# Autodesk Inventor assembly: rotate-translate
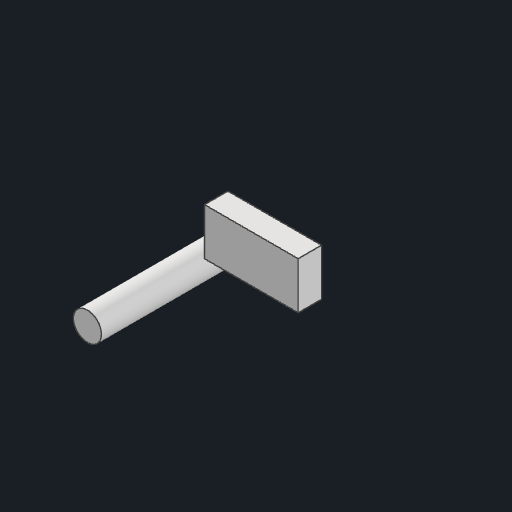
[picture p0: Inventor's stored thumbnail of the model, 512x512]
Saved by Autodesk Inventor 2026.1 (Build 301233000, 233)
## iProperties
Created: 2026-10-30
Part Number: rotate-translate
Document SubType Name: Assembly
Designer: anony
Author: anony
## Documents named in this file (3)
- C:\Users\anony\OneDrive\Desktop\AI Projects\CAD Convert\corpus\generated\asm\rotate-translate.iam
- C:\Users\anony\OneDrive\Desktop\AI Projects\CAD Convert\corpus\generated\asmparts\pin.ipt
- C:\Users\anony\OneDrive\Desktop\AI Projects\CAD Convert\corpus\generated\asmparts\box.ipt
## Components (2 placed, 2 different names)
1. pin:1 — Rotation/Translation:1
2. box:1 — Rotation/Translation:1
## Relationships (1: RelateRotateTranslate 1)
- Rotation/Translation:1 [RelateRotateTranslate] (2 mm): pin:1 ↔ box:1
